# Autodesk Inventor assembly: SPE3V1 Base Paciente
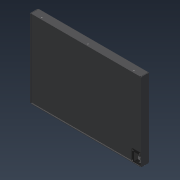
[picture p0: Inventor's stored thumbnail of the model, 180x180]
Saved by Autodesk Inventor 2021.2 (Build 252289000, 289)
## iProperties
Created: 2026-08-25
Part Number: SPE3V1 Base Paciente
Document SubType Name: Assembly
Designer: nelso
Mass: 16127.2 g
Surface Area: 31818.7 cm^2
Volume: 3944.79 cm^3
Density: 4.08822 g/cm^3
Description: ARMAR ENSAMBLE
Author: nelso
## Documents named in this file (11)
- C:\Users\Tecnica\OneDrive\Documentos\Mecanica\Soporte-Paciente-Espinografia\Workspace\SPE3V1 Base Paciente.iam
- C:\Users\Tecnica\OneDrive\Documentos\Mecanica\Soporte-Paciente-Espinografia\Workspace\SP43V1 Cubre Base.ipt
- C:\Users\Tecnica\OneDrive\Documentos\Mecanica\Soporte-Paciente-Espinografia\Workspace\RFPLUS4PO300 Tuerca rem M4 cab red.ipt
- C:\Users\Tecnica\OneDrive\Documentos\Mecanica\Soporte-Paciente-Espinografia\Workspace\DIN7991M4X0.8L12C.ipt
- C:\Users\Tecnica\OneDrive\Documentos\Mecanica\Soporte-Paciente-Espinografia\Workspace\SKU1009783 - PasadorSCMetalurgica58mm.iam
- C:\Users\Tecnica\OneDrive\Documentos\Mecanica\Soporte-Paciente-Espinografia\Workspace\SP45V1 Protector Pasador.ipt
- C:\Users\Tecnica\OneDrive\Documentos\Mecanica\Soporte-Paciente-Espinografia\Workspace\ISO7380M3X0.5L8I.ipt
- C:\Users\Tecnica\OneDrive\Documentos\Mecanica\Soporte-Paciente-Espinografia\Workspace\DIN555-5M3X0.5I.ipt
- C:\Users\Tecnica\OneDrive\Documentos\Mecanica\Soporte-Paciente-Espinografia\Workspace\SP44V1 Goma Base.ipt
- C:\Users\Tecnica\OneDrive\Documentos\Mecanica\Soporte-Paciente-Espinografia\Workspace\SPE7V1 Base Paciente (Soldadura).iam
- C:\Users\Tecnica\OneDrive\Documentos\Mecanica\Soporte-Paciente-Espinografia\Workspace\DIN125-A 3.2.ipt
## Components (26 placed, 10 different names)
1. SPE7V1 Base Paciente (Soldadura):1 [sub-assembly]
2. SP43V1 Cubre Base:1 — Mate:34, Mate:35, Mate:36, Mate:37, Mate:38
3. SP44V1 Goma Base:1
4. SP45V1 Protector Pasador:1 — Mate:36, Mate:37, Mate:38, Mate:39, Mate:40, Mate:41, Mate:42, Mate:43, Mate:44
5. SKU1009783 - PasadorSCMetalurgica58mm:1 [sub-assembly]
6. RFPLUS4PO300 Tuerca rem M4 cab red:1 — Mate:34
7. RFPLUS4PO300 Tuerca rem M4 cab red:2
8. RFPLUS4PO300 Tuerca rem M4 cab red:3
9. RFPLUS4PO300 Tuerca rem M4 cab red:4
10. RFPLUS4PO300 Tuerca rem M4 cab red:5
11. RFPLUS4PO300 Tuerca rem M4 cab red:6 — Mate:35
12. DIN7991M4X0.8L12C:1
13. DIN7991M4X0.8L12C:2
14. DIN7991M4X0.8L12C:3
15. DIN7991M4X0.8L12C:4
16. DIN7991M4X0.8L12C:5
17. DIN7991M4X0.8L12C:6
18. ISO7380M3X0.5L8I:1 — Mate:40, Mate:44, Mate:56
19. ISO7380M3X0.5L8I:2 — Mate:39, Mate:42, Mate:52
20. ISO7380M3X0.5L8I:3 — Mate:41, Mate:43, Mate:54
21. DIN125-A 3.2:1
22. DIN125-A 3.2:2
23. DIN125-A 3.2:3
24. DIN555-5M3X0.5I:1 — Mate:54
25. DIN555-5M3X0.5I:2 — Mate:56
26. DIN555-5M3X0.5I:3 — Mate:52
## Relationships (59: Mate 47, Flush 12)
- [Flush]: SPE7V1 Base Paciente (Soldadura):1 ↔ SP43V1 Cubre Base:1
- [Flush]: SPE7V1 Base Paciente (Soldadura):1 ↔ SP43V1 Cubre Base:1
- [Mate]: SPE7V1 Base Paciente (Soldadura):1 ↔ RFPLUS4PO300 Tuerca rem M4 cab red:6
- [Mate]: SPE7V1 Base Paciente (Soldadura):1 ↔ RFPLUS4PO300 Tuerca rem M4 cab red:5
- [Mate]: SPE7V1 Base Paciente (Soldadura):1 ↔ RFPLUS4PO300 Tuerca rem M4 cab red:4
- [Mate]: SPE7V1 Base Paciente (Soldadura):1 ↔ RFPLUS4PO300 Tuerca rem M4 cab red:1
- [Mate]: SPE7V1 Base Paciente (Soldadura):1 ↔ RFPLUS4PO300 Tuerca rem M4 cab red:2
- [Mate]: SPE7V1 Base Paciente (Soldadura):1 ↔ RFPLUS4PO300 Tuerca rem M4 cab red:3
- [Mate]: SPE7V1 Base Paciente (Soldadura):1 ↔ RFPLUS4PO300 Tuerca rem M4 cab red:1
- [Mate]: SPE7V1 Base Paciente (Soldadura):1 ↔ RFPLUS4PO300 Tuerca rem M4 cab red:2
- [Mate]: SPE7V1 Base Paciente (Soldadura):1 ↔ RFPLUS4PO300 Tuerca rem M4 cab red:3
- [Mate]: SPE7V1 Base Paciente (Soldadura):1 ↔ RFPLUS4PO300 Tuerca rem M4 cab red:4
- [Mate]: SPE7V1 Base Paciente (Soldadura):1 ↔ RFPLUS4PO300 Tuerca rem M4 cab red:5
- [Mate]: SPE7V1 Base Paciente (Soldadura):1 ↔ RFPLUS4PO300 Tuerca rem M4 cab red:6
- [Mate]: SPE7V1 Base Paciente (Soldadura):1 ↔ DIN7991M4X0.8L12C:1
- [Mate]: SPE7V1 Base Paciente (Soldadura):1 ↔ DIN7991M4X0.8L12C:2
- [Mate]: SPE7V1 Base Paciente (Soldadura):1 ↔ DIN7991M4X0.8L12C:3
- [Mate]: SPE7V1 Base Paciente (Soldadura):1 ↔ DIN7991M4X0.8L12C:4
- [Mate]: SPE7V1 Base Paciente (Soldadura):1 ↔ DIN7991M4X0.8L12C:5
- [Mate]: SPE7V1 Base Paciente (Soldadura):1 ↔ DIN7991M4X0.8L12C:6
- [Flush]: SPE7V1 Base Paciente (Soldadura):1 ↔ DIN7991M4X0.8L12C:3
- [Flush]: SPE7V1 Base Paciente (Soldadura):1 ↔ DIN7991M4X0.8L12C:2
- [Flush]: SPE7V1 Base Paciente (Soldadura):1 ↔ DIN7991M4X0.8L12C:1
- [Flush]: SPE7V1 Base Paciente (Soldadura):1 ↔ DIN7991M4X0.8L12C:6
- [Flush]: SPE7V1 Base Paciente (Soldadura):1 ↔ DIN7991M4X0.8L12C:5
- [Flush]: SPE7V1 Base Paciente (Soldadura):1 ↔ DIN7991M4X0.8L12C:4
- [Mate]: SPE7V1 Base Paciente (Soldadura):1 ↔ SP44V1 Goma Base:1
- [Mate]: SPE7V1 Base Paciente (Soldadura):1 ↔ SP44V1 Goma Base:1
- [Mate]: SPE7V1 Base Paciente (Soldadura):1 ↔ SP44V1 Goma Base:1
- [Mate]: SPE7V1 Base Paciente (Soldadura):1 ↔ SKU1009783 - PasadorSCMetalurgica58mm:1
- [Flush]: SPE7V1 Base Paciente (Soldadura):1 ↔ SKU1009783 - PasadorSCMetalurgica58mm:1
- [Mate]: SPE7V1 Base Paciente (Soldadura):1 ↔ SKU1009783 - PasadorSCMetalurgica58mm:1
- [Mate]: SPE7V1 Base Paciente (Soldadura):1 ↔ SKU1009783 - PasadorSCMetalurgica58mm:1
- Mate:34: SP43V1 Cubre Base:1 ↔ RFPLUS4PO300 Tuerca rem M4 cab red:1
- Mate:35: SP43V1 Cubre Base:1 ↔ RFPLUS4PO300 Tuerca rem M4 cab red:6
- [Flush]: SPE7V1 Base Paciente (Soldadura):1
- [Flush]: SPE7V1 Base Paciente (Soldadura):1
- [Flush]: SPE7V1 Base Paciente (Soldadura):1
- Mate:36: SP43V1 Cubre Base:1 ↔ SP45V1 Protector Pasador:1
- Mate:37: SP43V1 Cubre Base:1 ↔ SP45V1 Protector Pasador:1
- Mate:38: SP43V1 Cubre Base:1 ↔ SP45V1 Protector Pasador:1
- Mate:39: SP45V1 Protector Pasador:1 ↔ ISO7380M3X0.5L8I:2
- Mate:40: SP45V1 Protector Pasador:1 ↔ ISO7380M3X0.5L8I:1
- Mate:41: SP45V1 Protector Pasador:1 ↔ ISO7380M3X0.5L8I:3
- Mate:42: SP45V1 Protector Pasador:1 ↔ ISO7380M3X0.5L8I:2
- Mate:43: SP45V1 Protector Pasador:1 ↔ ISO7380M3X0.5L8I:3
- Mate:44: SP45V1 Protector Pasador:1 ↔ ISO7380M3X0.5L8I:1
- [Mate]: ISO7380M3X0.5L8I:3 ↔ DIN125-A 3.2:1
- [Mate]: ISO7380M3X0.5L8I:1 ↔ DIN125-A 3.2:2
- [Mate]: ISO7380M3X0.5L8I:2 ↔ DIN125-A 3.2:3
- [Mate]: SP43V1 Cubre Base:1 ↔ DIN125-A 3.2:3
- [Mate]: SP43V1 Cubre Base:1 ↔ DIN125-A 3.2:1
- [Mate]: SP43V1 Cubre Base:1 ↔ DIN125-A 3.2:2
- [Mate]: DIN125-A 3.2:3 ↔ DIN555-5M3X0.5I:3
- Mate:52: ISO7380M3X0.5L8I:2 ↔ DIN555-5M3X0.5I:3
- [Mate]: DIN125-A 3.2:1 ↔ DIN555-5M3X0.5I:1
- Mate:54: ISO7380M3X0.5L8I:3 ↔ DIN555-5M3X0.5I:1
- [Mate]: DIN125-A 3.2:2 ↔ DIN555-5M3X0.5I:2
- Mate:56: ISO7380M3X0.5L8I:1 ↔ DIN555-5M3X0.5I:2
